# Autodesk Inventor assembly: FinalAssembly
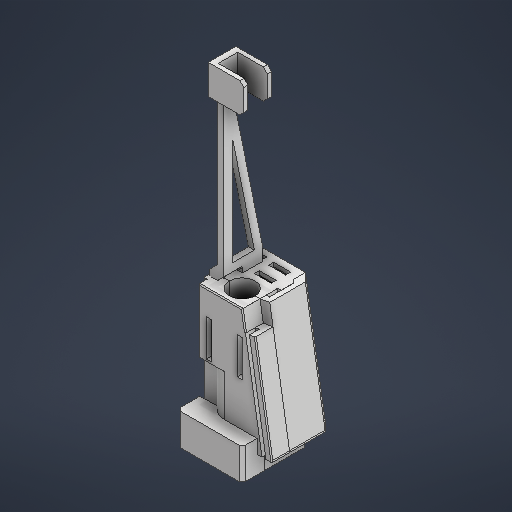
[picture p0: Inventor's stored thumbnail of the model, 512x512]
Saved by Autodesk Inventor 2026.3 (Build 303398000, 398)
## iProperties
Created: 2026-09-17
Part Number: FinalAssembly
Document SubType Name: Assembly
Designer: benfr
Author: benfr
## Documents named in this file (4)
- C:\Users\benfr\Downloads\FinalAssembly.iam
- C:\Users\benfr\Downloads\3.09_p4p\bottom2 (1).ipt
- C:\Users\benfr\Downloads\3.09_p4p\top2 (1).ipt
- E:\newextension2.ipt
## Components (3 placed, 3 different names)
1. bottom2 (1):1 — Mate:1
2. top2 (1):1 — Mate:1, Mate:2, Mate:3
3. newextension2:1 — Mate:2, Mate:3
## Relationships (3: Mate 3)
- Mate:1: bottom2 (1):1 ↔ top2 (1):1
- Mate:2: top2 (1):1 ↔ newextension2:1
- Mate:3: top2 (1):1 ↔ newextension2:1
